# Autodesk Inventor assembly: 1.2_CobotArm
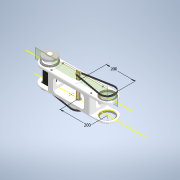
[picture p0: Inventor's stored thumbnail of the model, 180x180]
Saved by Autodesk Inventor 2021 (Build 250183000, 183)
## iProperties
Created: 2025-11-12
Part Number: 1.2_CobotArm
Document SubType Name: Assembly
Designer: Admin
Mass: 4507.89 g
Surface Area: 6162.32 cm^2
Volume: 2338.12 cm^3
Density: 1.92799 g/cm^3
Author: Admin
## Documents named in this file (26)
- C:\Users\Admin\OneDrive - Politecnico di Milano\File di Erwin Rafael Novicio - Industrial Robotics SY 25-26\3D Model\COBOT - no shaftkeys\1.2_CobotArm.iam
- C:\Users\Admin\OneDrive - Politecnico di Milano\File di Erwin Rafael Novicio - Industrial Robotics SY 25-26\3D Model\COBOT - no shaftkeys\1.2_1_SideArm.ipt
- C:\Users\Admin\OneDrive - Politecnico di Milano\File di Erwin Rafael Novicio - Industrial Robotics SY 25-26\3D Model\COBOT - no shaftkeys\HG-MR23B-K.ipt
- C:\Users\Admin\OneDrive - Politecnico di Milano\File di Erwin Rafael Novicio - Industrial Robotics SY 25-26\3D Model\COBOT - no shaftkeys\BEARING_61816-2RZ.ipt
- C:\Users\Admin\OneDrive - Politecnico di Milano\File di Erwin Rafael Novicio - Industrial Robotics SY 25-26\3D Model\COBOT - no shaftkeys\1.2_2_SideArmClose.ipt
- C:\Users\Admin\OneDrive - Politecnico di Milano\File di Erwin Rafael Novicio - Industrial Robotics SY 25-26\3D Model\COBOT - no shaftkeys\BEARING_61816-2RZ_MIR.ipt
- C:\Users\Admin\OneDrive - Politecnico di Milano\File di Erwin Rafael Novicio - Industrial Robotics SY 25-26\3D Model\COBOT - no shaftkeys\1.2_3_Shaft_A.ipt
- C:\Users\Admin\OneDrive - Politecnico di Milano\File di Erwin Rafael Novicio - Industrial Robotics SY 25-26\3D Model\COBOT - no shaftkeys\BEARING_61903-2RZ.ipt
- C:\Users\Admin\Documents\Inventor\Content Center Files\R2021\en-US\ISO 4762(2)\ISO 4762 - M5 x 30ISO.ipt
- C:\Users\Admin\Documents\Inventor\Content Center Files\R2021\en-US\ISO 7042(2)\ISO 7042 - M5 - ISO.ipt
- C:\Users\Admin\OneDrive - Politecnico di Milano\File di Erwin Rafael Novicio - Industrial Robotics SY 25-26\3D Model\COBOT - no shaftkeys\Timing_Pulley_22002-051020_V1.ipt
- C:\Users\Admin\Documents\Inventor\Content Center Files\R2021\en-US\DIN 835\DIN 835 - M4 x 25 - 0.7.ipt
- C:\Users\Admin\Documents\Inventor\Content Center Files\R2021\en-US\DIN 439-2\DIN 439 - M4 x 0.7.ipt
- C:\Users\Admin\Documents\Inventor\Content Center Files\R2021\en-US\DIN 555\DIN 555-5 - M4.ipt
- C:\Users\Admin\Documents\Inventor\Content Center Files\R2021\en-US\DIN 471(1)\DIN 471 - 30x1.5.ipt
- C:\Users\Admin\OneDrive - Politecnico di Milano\File di Erwin Rafael Novicio - Industrial Robotics SY 25-26\3D Model\COBOT - no shaftkeys\Timing_Pulley_22002-051060_V2.ipt
- C:\Users\Admin\Documents\Inventor\Content Center Files\R2021\en-US\DIN 471(1)\DIN 471 - 14x1.ipt
- C:\Users\Admin\OneDrive - Politecnico di Milano\File di Erwin Rafael Novicio - Industrial Robotics SY 25-26\3D Model\COBOT - no shaftkeys\Timing_Pulley_22002-051060_V1.ipt
- C:\Users\Admin\OneDrive - Politecnico di Milano\File di Erwin Rafael Novicio - Industrial Robotics SY 25-26\3D Model\COBOT - no shaftkeys\Timing_Pulley_22002-051015.ipt
- C:\Users\Admin\Documents\Inventor\Content Center Files\R2021\en-US\DIN 471(1)\DIN 471 - 10x1.ipt
- C:\Users\Admin\OneDrive - Politecnico di Milano\File di Erwin Rafael Novicio - Industrial Robotics SY 25-26\3D Model\COBOT - no shaftkeys\1.2_4_SpacerA.ipt
- C:\Users\Admin\OneDrive - Politecnico di Milano\File di Erwin Rafael Novicio - Industrial Robotics SY 25-26\3D Model\COBOT - no shaftkeys\1.2_5_SpacerB.ipt
- C:\Users\Admin\OneDrive - Politecnico di Milano\File di Erwin Rafael Novicio - Industrial Robotics SY 25-26\3D Model\COBOT - no shaftkeys\M6 Unheaded Heat-Sert Insert for Plastic.ipt
- C:\Users\Admin\Documents\Inventor\Content Center Files\R2021\en-US\ISO 4762(2)\ISO 4762 - M6 x 16ISO.ipt
- C:\Users\Admin\OneDrive - Politecnico di Milano\File di Erwin Rafael Novicio - Industrial Robotics SY 25-26\3D Model\COBOT - no shaftkeys\TiminigBelt_A.ipt
- C:\Users\Admin\OneDrive - Politecnico di Milano\File di Erwin Rafael Novicio - Industrial Robotics SY 25-26\3D Model\COBOT - no shaftkeys\TiminigBelt_C.ipt
## Components (40 placed, 25 different names)
1. 1.2_1_SideArm:1 — Mate:1, Flush:1, Flush:2, Mate:2, Mate:3, Mate:4, Mate:5, Mate:6, Mate:7, Mate:8, Mate:9, Mate:10, Mate:11, Mate:23, Mate:37, Mate:39, Mate:40, Mate:41, Mate:42, Mate:47, Mate:93, Mate:94, Mate:95, Mate:96, Flush:5, Flush:6, Flush:7, Flush:8
2. HG-KR23B:1 — Mate:2, Mate:3, Mate:4, Mate:35, Mate:36, Mate:50, Mate:88
3. BEARING_61816-2RZ:1 — Mate:7, Mate:8
4. BEARING_61816-2RZ:2 — Mate:5, Mate:6, Angle:2
5. 1.2_2_SideArmClose:1 — Mate:9, Mate:10, Mate:11, Mate:21, Mate:22, Mate:57, Mate:58, Mate:59, Mate:61, Mate:85, Mate:86, Mate:87, Mate:97, Mate:98, Mate:102, Angle:1, Angle:2
6. BEARING_61816-2RZ_MIR:1 — Mate:85, Mate:86
7. BEARING_61816-2RZ_MIR:2 — Mate:21, Mate:22, Angle:1
8. 1.2_3_Shaft_A:1 — Mate:23, Flush:4, Mate:27, Mate:28, Mate:29, Mate:30, Mate:48, Mate:65, Mate:66, Mate:67, Mate:69, Mate:73, Mate:75, Mate:76, Mate:80, Mate:101
9. BEARING_61903-2RZ:1 — Mate:27, Mate:30
10. BEARING_61903-2RZ:2 — Mate:28, Mate:29
11. ISO 4762 M6 x 16:2 — Mate:39, Mate:97
12. ISO 4762 M6 x 16:4 — Mate:41, Flush:9
13. ISO 4762 M6 x 16:1 — Mate:40, Flush:10
14. ISO 4762 M6 x 16:3 — Mate:42, Flush:9, Flush:10, Mate:98
15. Timing_Pulley_22002-051020_V1:1 — Mate:47, Mate:48, Mate:49, Mate:83, Mate:99, Flush:12
16. DIN 835 M4 x 25:1 — Mate:49, Mate:50, Mate:53, Mate:82
17. DIN 439-2 - replaced by DIN EN 24035/28675 M4:1 — Mate:51, Mate:52, Mate:53
18. DIN 555 - replaced by DIN EN 24034 M4:1 — Mate:51, Mate:52, Mate:84
19. DIN 471 30x1.5:1 — Mate:57, Mate:58
20. Timing_Pulley_22002-051060_V2:1 — Mate:59, Mate:61
21. DIN 471 14x1:1 — Mate:65, Mate:66
22. Timing_Pulley_22002-051060_V1:1 — Mate:67, Mate:69, Mate:100
23. Timing_Pulley_22002-051015:1 — Mate:73, Mate:75, Flush:13
24. DIN 471 10x1:1 — Mate:76, Mate:80
25. 1.2_4_SpacerA:1 — Mate:82, Mate:83, Mate:84
26. 1.2_5_SpacerB:1 — Mate:87, Mate:88, Flush:11
27. M6 Unheaded Heat-Sert Insert for Plastic:1 — Mate:93, Flush:8
28. M6 Unheaded Heat-Sert Insert for Plastic:2 — Mate:96, Flush:6
29. M6 Unheaded Heat-Sert Insert for Plastic:3 — Mate:95, Flush:5
30. M6 Unheaded Heat-Sert Insert for Plastic:4 — Mate:94, Flush:7
31. TiminigBelt_A:1 — Mate:99, Mate:100, Flush:12
32. TiminigBelt_C:1 — Mate:101, Mate:102, Flush:13
33. ISO 7042 M5:1 — Mate:37, Mate:38
34. ISO 4762 M5 x 30:1 — Mate:35, Mate:36, Mate:38
35. ISO 7042 M5:2
36. ISO 4762 M5 x 30:2
37. ISO 7042 M5:3
38. ISO 4762 M5 x 30:3
39. ISO 7042 M5:4
40. ISO 4762 M5 x 30:4
## Component patterns: (4 elements, first: ISO 7042 M5:1 + ISO 4762 M5 x 30:1)
## Relationships (76: Mate 62, Flush 12, Angle 2)
- Mate:1 (-55 mm): 1.2_1_SideArm:1
- Flush:1: 1.2_1_SideArm:1
- Flush:2: 1.2_1_SideArm:1
- Mate:2: 1.2_1_SideArm:1 ↔ HG-KR23B:1
- Mate:3: 1.2_1_SideArm:1 ↔ HG-KR23B:1
- Mate:4: 1.2_1_SideArm:1 ↔ HG-KR23B:1
- Mate:5: 1.2_1_SideArm:1 ↔ BEARING_61816-2RZ:2
- Mate:6: 1.2_1_SideArm:1 ↔ BEARING_61816-2RZ:2
- Mate:7: 1.2_1_SideArm:1 ↔ BEARING_61816-2RZ:1
- Mate:8: 1.2_1_SideArm:1 ↔ BEARING_61816-2RZ:1
- Mate:9: 1.2_1_SideArm:1 ↔ 1.2_2_SideArmClose:1
- Mate:10: 1.2_1_SideArm:1 ↔ 1.2_2_SideArmClose:1
- Mate:11: 1.2_1_SideArm:1 ↔ 1.2_2_SideArmClose:1
- Mate:21: 1.2_2_SideArmClose:1 ↔ BEARING_61816-2RZ_MIR:2
- Mate:22: 1.2_2_SideArmClose:1 ↔ BEARING_61816-2RZ_MIR:2
- Mate:23: 1.2_1_SideArm:1 ↔ 1.2_3_Shaft_A:1
- Flush:4: 1.2_3_Shaft_A:1
- Mate:27: 1.2_3_Shaft_A:1 ↔ BEARING_61903-2RZ:1
- Mate:28: 1.2_3_Shaft_A:1 ↔ BEARING_61903-2RZ:2
- Mate:29: 1.2_3_Shaft_A:1 ↔ BEARING_61903-2RZ:2
- Mate:30: 1.2_3_Shaft_A:1 ↔ BEARING_61903-2RZ:1
- Mate:35: HG-KR23B:1 ↔ ISO 4762 M5 x 30:1
- Mate:36: HG-KR23B:1 ↔ ISO 4762 M5 x 30:1
- Mate:37: 1.2_1_SideArm:1 ↔ ISO 7042 M5:1
- Mate:38: ISO 7042 M5:1 ↔ ISO 4762 M5 x 30:1
- Mate:39: 1.2_1_SideArm:1 ↔ ISO 4762 M6 x 16:2
- Mate:40: 1.2_1_SideArm:1 ↔ ISO 4762 M6 x 16:1
- Mate:41: 1.2_1_SideArm:1 ↔ ISO 4762 M6 x 16:4
- Mate:42: 1.2_1_SideArm:1 ↔ ISO 4762 M6 x 16:3
- Mate:47: 1.2_1_SideArm:1 ↔ Timing_Pulley_22002-051020_V1:1
- Mate:48: 1.2_3_Shaft_A:1 ↔ Timing_Pulley_22002-051020_V1:1
- Mate:49: Timing_Pulley_22002-051020_V1:1 ↔ DIN 835 M4 x 25:1
- Mate:50 (-13 mm): HG-KR23B:1 ↔ DIN 835 M4 x 25:1
- Mate:51: DIN 439-2 - replaced by DIN EN 24035/28675 M4:1 ↔ DIN 555 - replaced by DIN EN 24034 M4:1
- Mate:52: DIN 439-2 - replaced by DIN EN 24035/28675 M4:1 ↔ DIN 555 - replaced by DIN EN 24034 M4:1
- Mate:53: DIN 835 M4 x 25:1 ↔ DIN 439-2 - replaced by DIN EN 24035/28675 M4:1
- Mate:57: 1.2_2_SideArmClose:1 ↔ DIN 471 30x1.5:1
- Mate:58: 1.2_2_SideArmClose:1 ↔ DIN 471 30x1.5:1
- Mate:59: 1.2_2_SideArmClose:1 ↔ Timing_Pulley_22002-051060_V2:1
- Mate:61: 1.2_2_SideArmClose:1 ↔ Timing_Pulley_22002-051060_V2:1
- Mate:65: 1.2_3_Shaft_A:1 ↔ DIN 471 14x1:1
- Mate:66: 1.2_3_Shaft_A:1 ↔ DIN 471 14x1:1
- Mate:67: 1.2_3_Shaft_A:1 ↔ Timing_Pulley_22002-051060_V1:1
- Mate:69: 1.2_3_Shaft_A:1 ↔ Timing_Pulley_22002-051060_V1:1
- Mate:73: 1.2_3_Shaft_A:1 ↔ Timing_Pulley_22002-051015:1
- Mate:75: 1.2_3_Shaft_A:1 ↔ Timing_Pulley_22002-051015:1
- Mate:76: 1.2_3_Shaft_A:1 ↔ DIN 471 10x1:1
- Mate:80: 1.2_3_Shaft_A:1 ↔ DIN 471 10x1:1
- Mate:82: DIN 835 M4 x 25:1 ↔ 1.2_4_SpacerA:1
- Mate:83: Timing_Pulley_22002-051020_V1:1 ↔ 1.2_4_SpacerA:1
- Mate:84: DIN 555 - replaced by DIN EN 24034 M4:1 ↔ 1.2_4_SpacerA:1
- Mate:85: 1.2_2_SideArmClose:1 ↔ BEARING_61816-2RZ_MIR:1
- Mate:86: 1.2_2_SideArmClose:1 ↔ BEARING_61816-2RZ_MIR:1
- Mate:87: 1.2_2_SideArmClose:1 ↔ 1.2_5_SpacerB:1
- Mate:88: HG-KR23B:1 ↔ 1.2_5_SpacerB:1
- Mate:93: 1.2_1_SideArm:1 ↔ M6 Unheaded Heat-Sert Insert for Plastic:1
- Mate:94: 1.2_1_SideArm:1 ↔ M6 Unheaded Heat-Sert Insert for Plastic:4
- Mate:95: 1.2_1_SideArm:1 ↔ M6 Unheaded Heat-Sert Insert for Plastic:3
- Mate:96: 1.2_1_SideArm:1 ↔ M6 Unheaded Heat-Sert Insert for Plastic:2
- Flush:5: 1.2_1_SideArm:1 ↔ M6 Unheaded Heat-Sert Insert for Plastic:3
- Flush:6: 1.2_1_SideArm:1 ↔ M6 Unheaded Heat-Sert Insert for Plastic:2
- Flush:7: 1.2_1_SideArm:1 ↔ M6 Unheaded Heat-Sert Insert for Plastic:4
- Flush:8: 1.2_1_SideArm:1 ↔ M6 Unheaded Heat-Sert Insert for Plastic:1
- Mate:97: 1.2_2_SideArmClose:1 ↔ ISO 4762 M6 x 16:2
- Flush:9: ISO 4762 M6 x 16:4 ↔ ISO 4762 M6 x 16:3
- Flush:10: ISO 4762 M6 x 16:1 ↔ ISO 4762 M6 x 16:3
- Mate:98: 1.2_2_SideArmClose:1 ↔ ISO 4762 M6 x 16:3
- Flush:11: 1.2_5_SpacerB:1
- Mate:99: Timing_Pulley_22002-051020_V1:1 ↔ TiminigBelt_A:1
- Mate:100: Timing_Pulley_22002-051060_V1:1 ↔ TiminigBelt_A:1
- Flush:12 (-2.5 mm): Timing_Pulley_22002-051020_V1:1 ↔ TiminigBelt_A:1
- Mate:101: 1.2_3_Shaft_A:1 ↔ TiminigBelt_C:1
- Mate:102: 1.2_2_SideArmClose:1 ↔ TiminigBelt_C:1
- Flush:13 (2.5 mm): Timing_Pulley_22002-051015:1 ↔ TiminigBelt_C:1
- Angle:1 (0 deg): 1.2_2_SideArmClose:1 ↔ BEARING_61816-2RZ_MIR:2
- Angle:2 (0 deg): BEARING_61816-2RZ:2 ↔ 1.2_2_SideArmClose:1
